# Autodesk Inventor assembly: ARD_Model_v1
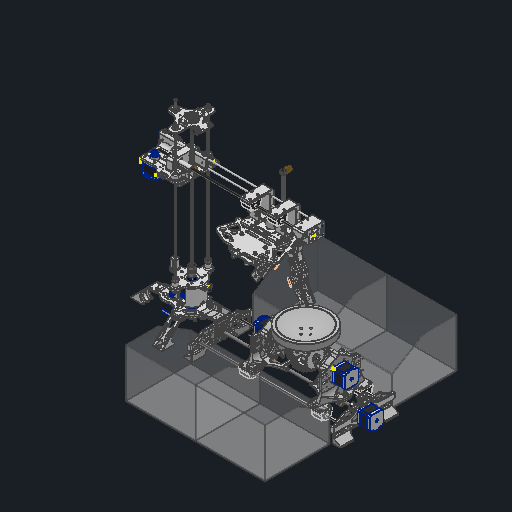
[picture p0: Inventor's stored thumbnail of the model, 512x512]
Saved by Autodesk Inventor 2026.3 (Build 303398000, 398)
## iProperties
Created: 2026-03-18
Part Number: ARD_Model_v1
Document SubType Name: Assembly
Designer: work
Author: work
## Documents named in this file (32)
- C:\Users\khw\Desktop\ARD_v1\ARD_Model_v1.iam
- C:\Users\khw\Desktop\ARD_v1\ARD_hardware\ARD_Model_v1\1\A.ipt
- C:\Users\khw\Desktop\ARD_v1\ARD_hardware\ARD_Model_v1\C.ipt
- C:\Users\khw\Desktop\ARD_v1\ARD_hardware\ARD_Model_v1\Object\JIS B 1521 SKF (D) - SKF 608-Z.ipt
- C:\Users\khw\Desktop\ARD_v1\ARD_hardware\ARD_Model_v1\5_Co.ipt
- C:\Users\khw\Desktop\ARD_v1\ARD_hardware\ARD_Model_v1\NEMA17.ipt
- C:\Users\khw\Desktop\ARD_v1\ARD_hardware\ARD_Model_v1\1\B.ipt
- C:\Users\khw\Desktop\ARD_v1\ARD_hardware\ARD_Model_v1\Object\T8_LeadNut.ipt
- C:\Users\khw\Desktop\ARD_v1\ARD_hardware\ARD_Model_v1\Object\8T_Shaft.ipt
- C:\Users\khw\Desktop\ARD_v1\ARD_hardware\ARD_Model_v1\Object\T8_BellowsCoulping.ipt
- C:\Users\khw\Desktop\ARD_v1\ARD_hardware\ARD_Model_v1\Object\8T_ScrewShaft.ipt
- C:\Users\khw\Desktop\ARD_v1\ARD_hardware\ARD_Model_v1\Object\LeadWay.ipt
- C:\Users\khw\Desktop\ARD_v1\ARD_hardware\ARD_Model_v1\UR_rail_R_LinearWayCopler_v3.ipt
- C:\Users\khw\Desktop\ARD_v1\ARD_hardware\ARD_Model_v1\Object\KS B 1003 - M 3 x 20.ipt
- C:\Users\khw\Desktop\ARD_v1\ARD_hardware\ARD_Model_v1\Object\KS B 1003 - M 3 x 12.ipt
- C:\Users\khw\Desktop\ARD_v1\ARD_hardware\PL121248m2Drive_v2\pl_v1.iam
- C:\Users\khw\Desktop\ARD_v1\ARD_hardware\ARD_Model_v1\UR_rail_LeadNutHolder_v1.ipt
- C:\Users\khw\Desktop\ARD_v1\ARD_hardware\Rali_v1\stand_v2.ipt
- C:\Users\khw\Desktop\ARD_v1\ARD_hardware\Rali_v1\stand1.ipt
- C:\Users\khw\Desktop\ARD_v1\ARD_hardware\Rali_v1\vl53_hoder.ipt
- C:\Users\khw\Desktop\ARD_v1\ARD_hardware\Rali_v1\stand12.ipt
- C:\Users\khw\Desktop\ARD_v1\ARD_hardware\RA_Project\RA_v1.iam
- C:\Users\khw\Desktop\ARD_v1\ARD_hardware\RA_Project\rali-x support_V2.ipt
- C:\Users\khw\Desktop\ARD_v1\ARD_hardware\RA_Project\VL53L0X.ipt
- C:\Users\khw\Desktop\ARD_v1\ARD_hardware\Rali_v1\liner608_holder.ipt
- C:\Users\khw\Desktop\ARD_v1\ARD_hardware\ARD_Model_v1\Object\box big.ipt
- C:\Users\khw\Desktop\ARD_v1\ARD_hardware\ARD_Model_v1\접시.ipt
- C:\Users\khw\Documents\KS B 1003 - M 3 x 10.ipt
- C:\Users\khw\Desktop\ARD_v1\ARD_hardware\ARD_Model_v1\2B_set\AIP\FEA\fdflh83ds.fins
- C:\Users\khw\Desktop\ARD_v1\ARD_hardware\ARD_Model_v1\2B_set\AIP\FEA\fdflh83ds.fsat
- C:\Users\khw\Desktop\ARD_v1\ARD_hardware\ARD_Model_v1\2B_set\AIP\FEA\fdflh83ds.ftes
- C:\Users\khw\Desktop\ARD_v1\ARD_hardware\ARD_Model_v1\2B_set\AIP\FEA\fdflh83ds.fwiz
## Components (121 placed, 27 different names)
1. stand_v2:1 — 메이트:165, 각도:12, 메이트:166, 메이트:167, 각도:16, 메이트:188, 메이트:189, 메이트:190, 메이트:193, 각도:24, 플러쉬:12, 플러쉬:14, 메이트:219, 삽입:34, 삽입:35, 삽입:36, 삽입:37
2. stand1:1 — 메이트:170, 메이트:171, 메이트:172, 메이트:173, 메이트:174, 메이트:175, 메이트:176, 메이트:177, 메이트:178, 플러쉬:10, 각도:14, 삽입:14, 삽입:15, 삽입:16, 삽입:17, 삽입:18, 삽입:19, 삽입:20, 삽입:21
3. stand1:2 — 메이트:179, 메이트:180, 메이트:181, 메이트:182, 메이트:183, 메이트:184, 메이트:185, 플러쉬:9, 메이트:186, 각도:16, 각도:22, 삽입:5, 삽입:6, 삽입:7, 삽입:8, 삽입:9, 삽입:38, 삽입:39, 삽입:40
4. vl53_hoder:1 — 메이트:188, 메이트:189, 메이트:190, 메이트:204, 메이트:205, 각도:21, 삽입:10, 삽입:11, 삽입:12, 삽입:13
5. stand12:1 — 메이트:191, 메이트:192, 각도:17, 메이트:193, 메이트:194
6. stand12:2 — 메이트:196, 메이트:197, 각도:19, 각도:20, 메이트:212, 삽입:26, 삽입:27, 삽입:28, 삽입:29, 메이트:226, 메이트:227
7. RA_v1:1 [sub-assembly] — 각도:19, 각도:20, 메이트:198, 메이트:201, 메이트:202
8. rali-x support_V2:1 — 메이트:198, 메이트:201, 메이트:202, 메이트:209, 메이트:210, 메이트:211
9. VL53L0X:1 — 메이트:204, 메이트:205, 각도:21
10. stand_v2:2 — 메이트:208, 메이트:209, 메이트:210, 메이트:211, 플러쉬:11, 메이트:212, 각도:24, 메이트:213, 메이트:214, 메이트:215, 메이트:218
11. liner608_holder:1 — 메이트:213, 메이트:214, 메이트:215, 메이트:217, 삽입:30, 삽입:31, 삽입:32, 삽입:33
12. JIS B 1521 SKF (D) - SKF 608-Z:5 — 메이트:216, 메이트:217
13. box big:1 — 메이트:218, 플러쉬:12, 메이트:226
14. box big:2 — 플러쉬:14, 메이트:219, 메이트:227
15. 접시:1 — 메이트:222, 메이트:223, 메이트:224, 삽입:22, 삽입:23, 삽입:24, 삽입:25
16. UR_rail_LeadNutHolder_v1:3 — 회전/변환:2, 플러쉬:9, 메이트:186
17. UR_rail_R_LinearWayCopler_v3:1 — 메이트:68, 메이트:69, 메이트:70, 회전:1, 회전:2, 회전:3, 회전:4, 메이트:173, 메이트:174, 메이트:175
18. UR_rail_R_LinearWayCopler_v3:3 — 메이트:176, 메이트:177, 메이트:178
19. B:2 — 회전:3
20. A:1 — 메이트:1, 메이트:2, 메이트:11, 메이트:22, 메이트:23, 회전:1, 메이트:163
21. C:1 — 메이트:7, 메이트:8, 메이트:9, 메이트:10, 메이트:11, 메이트:27, 메이트:50, 플러쉬:3
22. A:2 — 메이트:10, 메이트:21, 메이트:24, 회전:2, 메이트:159, 메이트:162
23. 5_Co:4 — 메이트:22, 메이트:23, 메이트:225
24. 5_Co:3 — 메이트:21, 메이트:24, 회전:3, 메이트:159, 메이트:160, 메이트:161
25. B:1 — 메이트:25, 메이트:26, 메이트:27, 회전:1, 회전:2, 각도:22, 메이트:222, 메이트:223, 메이트:224
26. KS B 1003 - M 3 x 10:1 — 삽입:5
27. KS B 1003 - M 3 x 10:2 — 삽입:6
28. KS B 1003 - M 3 x 10:3 — 삽입:7
29. KS B 1003 - M 3 x 10:4 — 삽입:8
30. KS B 1003 - M 3 x 10:5 — 삽입:9
31. KS B 1003 - M 3 x 10:6 — 삽입:10
32. KS B 1003 - M 3 x 10:7 — 삽입:11
33. KS B 1003 - M 3 x 10:8 — 삽입:12
34. KS B 1003 - M 3 x 10:9 — 삽입:13
35. KS B 1003 - M 3 x 10:10 — 삽입:14
36. KS B 1003 - M 3 x 10:11 — 삽입:15
37. KS B 1003 - M 3 x 10:12 — 삽입:16
38. KS B 1003 - M 3 x 10:13 — 삽입:17
39. KS B 1003 - M 3 x 10:14 — 삽입:18
40. KS B 1003 - M 3 x 10:15 — 삽입:19
41. KS B 1003 - M 3 x 10:16 — 삽입:20
42. KS B 1003 - M 3 x 10:17 — 삽입:21
43. KS B 1003 - M 3 x 10:18 — 삽입:22
44. KS B 1003 - M 3 x 10:19 — 삽입:23
45. KS B 1003 - M 3 x 10:20 — 삽입:24
46. KS B 1003 - M 3 x 10:21 — 삽입:25
47. KS B 1003 - M 3 x 10:22 — 삽입:26
48. KS B 1003 - M 3 x 10:23 — 삽입:27
49. KS B 1003 - M 3 x 10:24 — 삽입:28
50. KS B 1003 - M 3 x 10:25 — 삽입:29
51. KS B 1003 - M 3 x 10:26 — 삽입:30
52. KS B 1003 - M 3 x 10:27 — 삽입:31
53. KS B 1003 - M 3 x 10:28 — 삽입:32
54. KS B 1003 - M 3 x 10:29 — 삽입:33
55. KS B 1003 - M 3 x 10:30 — 삽입:34
56. KS B 1003 - M 3 x 10:31 — 삽입:35
57. KS B 1003 - M 3 x 10:32 — 삽입:36
58. KS B 1003 - M 3 x 10:33 — 삽입:37
59. KS B 1003 - M 3 x 10:34 — 삽입:38
60. KS B 1003 - M 3 x 10:35 — 삽입:39
61. KS B 1003 - M 3 x 10:36 — 삽입:40
62. KS B 1003 - M 3 x 20:27
63. KS B 1003 - M 3 x 20:28
64. KS B 1003 - M 3 x 20:29
65. KS B 1003 - M 3 x 20:30
66. KS B 1003 - M 3 x 20:18 — 회전:31
67. KS B 1003 - M 3 x 20:19 — 회전:32
68. KS B 1003 - M 3 x 20:20 — 삽입:1
69. KS B 1003 - M 3 x 20:21 — 회전:34
70. KS B 1003 - M 3 x 20:22 — 삽입:2, 메이트:171
71. KS B 1003 - M 3 x 20:24 — 회전:35
72. KS B 1003 - M 3 x 20:25 — 회전:33, 메이트:170
73. KS B 1003 - M 3 x 20:26 — 회전:36
74. KS B 1003 - M 3 x 12:8 — 회전:20
75. KS B 1003 - M 3 x 12:5
76. KS B 1003 - M 3 x 12:6
77. KS B 1003 - M 3 x 12:7 — 메이트:134
78. KS B 1003 - M 3 x 20:1 — 회전:1
79. KS B 1003 - M 3 x 20:3 — 회전:3
80. KS B 1003 - M 3 x 20:4 — 회전:2
81. KS B 1003 - M 3 x 20:5 — 회전:4
82. JIS B 1521 SKF (D) - SKF 608-Z:4 — 메이트:50, 플러쉬:3
83. KS B 1003 - M 3 x 20:13
84. KS B 1003 - M 3 x 20:12
85. KS B 1003 - M 3 x 20:11
86. KS B 1003 - M 3 x 20:10
87. KS B 1003 - M 3 x 12:9
88. KS B 1003 - M 3 x 12:10
89. KS B 1003 - M 3 x 12:11
90. KS B 1003 - M 3 x 12:12
91. KS B 1003 - M 3 x 20:31
92. KS B 1003 - M 3 x 20:32
93. KS B 1003 - M 3 x 20:33
94. KS B 1003 - M 3 x 20:34
95. KS B 1003 - M 3 x 20:35
96. KS B 1003 - M 3 x 20:36
97. KS B 1003 - M 3 x 20:37
98. KS B 1003 - M 3 x 20:38 — 메이트:179
99. KS B 1003 - M 3 x 20:39
100. KS B 1003 - M 3 x 20:40
101. KS B 1003 - M 3 x 20:41 — 메이트:180
102. KS B 1003 - M 3 x 20:42
103. UR_rail_LeadNutHolder_v1:2 — 메이트:132, 메이트:133, 메이트:134, 플러쉬:10, 각도:14
104. LeadWay:5 — 메이트:156
105. UR_rail_R_LinearWayCopler_v3:5 — 메이트:181, 메이트:182
106. T8_LeadNut:3 — 메이트:187
107. LeadWay:6 — 메이트:157
108. UR_rail_R_LinearWayCopler_v3:6 — 메이트:183, 메이트:184
109. pl_v1:2 [sub-assembly] — 메이트:161, 메이트:162, 메이트:185
110. pl_v1:1 [sub-assembly] — 회전:31, 회전:32, 삽입:1, 삽입:2, 회전:33, 회전:34, 회전:35, 회전:36, 메이트:160, 메이트:163, 메이트:172, 메이트:225
111. T8_LeadNut:2 — 회전:20, 메이트:132, 메이트:133, 메이트:158
112. 8T_Shaft:2 — 플러쉬:7, 메이트:156, 메이트:194, 메이트:197, 플러쉬:11
113. LeadWay:3
114. NEMA17:3 — 메이트:110, 메이트:111, 각도:10, 각도:12, 메이트:191, 메이트:192, 각도:17
115. 8T_Shaft:1 — 메이트:71, 플러쉬:7, 메이트:157
116. T8_BellowsCoulping:1 — 메이트:84, 메이트:85, 메이트:110, 메이트:111, 회전:4, 각도:10, 회전/변환:2
117. 8T_ScrewShaft:1 — 메이트:84, 메이트:85, 회전:4, 메이트:158, 메이트:165, 메이트:187, 메이트:196, 메이트:208, 메이트:216
118. LeadWay:1 — 메이트:68, 메이트:69, 메이트:70, 메이트:71
119. JIS B 1521 SKF (D) - SKF 608-Z:2 — 메이트:8
120. JIS B 1521 SKF (D) - SKF 608-Z:3 — 메이트:7, 메이트:25, 메이트:26
121. JIS B 1521 SKF (D) - SKF 608-Z:1 — 메이트:1, 메이트:2, 메이트:9
## Relationships (202: Mate 104, Insert 40, RevoluteJoint 34, Angle 10, Flush 7, RelateRotation 4, WeldJoint 2, RelateRotateTranslate 1)
- 메이트:1 [Mate]: A:1 ↔ JIS B 1521 SKF (D) - SKF 608-Z:1
- 메이트:2 [Mate]: A:1 ↔ JIS B 1521 SKF (D) - SKF 608-Z:1
- [Mate]: A:2 ↔ JIS B 1521 SKF (D) - SKF 608-Z:2
- [Mate]: A:2 ↔ JIS B 1521 SKF (D) - SKF 608-Z:2
- 메이트:7 [Mate]: C:1 ↔ JIS B 1521 SKF (D) - SKF 608-Z:3
- 메이트:8 [Mate]: C:1 ↔ JIS B 1521 SKF (D) - SKF 608-Z:2
- 메이트:9 [Mate]: C:1 ↔ JIS B 1521 SKF (D) - SKF 608-Z:1
- 메이트:10 [Mate]: C:1 ↔ A:2
- 메이트:11 [Mate]: A:1 ↔ C:1
- 메이트:21 [Mate]: A:2 ↔ 5_Co:3
- 메이트:22 [Mate]: A:1 ↔ 5_Co:4
- 메이트:23 [Mate]: A:1 ↔ 5_Co:4
- 메이트:24 [Mate]: A:2 ↔ 5_Co:3
- 메이트:25 [Mate]: B:1 ↔ JIS B 1521 SKF (D) - SKF 608-Z:3
- 메이트:26 [Mate]: B:1 ↔ JIS B 1521 SKF (D) - SKF 608-Z:3
- 메이트:27 [Mate]: C:1 ↔ B:1
- 회전:1 [RelateRotation] (1 ul): A:1 ↔ B:1
- 회전:2 [RelateRotation] (1 ul): A:2 ↔ B:1
- [Mate]: B:2 ↔ JIS B 1521 SKF (D) - SKF 608-Z:4
- [Mate]: B:2 ↔ JIS B 1521 SKF (D) - SKF 608-Z:4
- 메이트:50 [Mate]: C:1 ↔ JIS B 1521 SKF (D) - SKF 608-Z:4
- 플러쉬:3 [Flush]: C:1 ↔ JIS B 1521 SKF (D) - SKF 608-Z:4
- 회전:3 [RelateRotation] (1 ul): B:2 ↔ 5_Co:3
- 메이트:68 [Mate]: UR_rail_R_LinearWayCopler_v3:1 ↔ LeadWay:1
- 메이트:69 [Mate]: UR_rail_R_LinearWayCopler_v3:1 ↔ LeadWay:1
- 메이트:70 [Mate]: UR_rail_R_LinearWayCopler_v3:1 ↔ LeadWay:1
- 메이트:71 [Mate]: 8T_Shaft:1 ↔ LeadWay:1
- 회전:1 [RevoluteJoint]: UR_rail_R_LinearWayCopler_v3:1 ↔ KS B 1003 - M 3 x 20:1
- 회전:2 [RevoluteJoint]: UR_rail_R_LinearWayCopler_v3:1 ↔ KS B 1003 - M 3 x 20:4
- 회전:3 [RevoluteJoint]: UR_rail_R_LinearWayCopler_v3:1 ↔ KS B 1003 - M 3 x 20:3
- 회전:4 [RevoluteJoint]: UR_rail_R_LinearWayCopler_v3:1 ↔ KS B 1003 - M 3 x 20:5
- 메이트:84 [Mate]: T8_BellowsCoulping:1 ↔ 8T_ScrewShaft:1
- 메이트:85 [Mate] (-10 mm): T8_BellowsCoulping:1 ↔ 8T_ScrewShaft:1
- [RevoluteJoint]: KS B 1003 - M 3 x 12:5 ↔ T8_LeadNut:2
- [WeldJoint]: KS B 1003 - M 3 x 12:6 ↔ T8_LeadNut:2
- [RevoluteJoint]: KS B 1003 - M 3 x 12:7 ↔ T8_LeadNut:2
- 회전:20 [RevoluteJoint]: KS B 1003 - M 3 x 12:8 ↔ T8_LeadNut:2
- [Mate]: UR_rail_R_LinearWayCopler_v3:3 ↔ LeadWay:3
- [Mate]: UR_rail_R_LinearWayCopler_v3:3 ↔ LeadWay:3
- [Mate]: UR_rail_R_LinearWayCopler_v3:3 ↔ LeadWay:3
- [Mate]: 8T_Shaft:2 ↔ LeadWay:3
- [RevoluteJoint]: UR_rail_R_LinearWayCopler_v3:3 ↔ KS B 1003 - M 3 x 20:10
- [RevoluteJoint]: UR_rail_R_LinearWayCopler_v3:3 ↔ KS B 1003 - M 3 x 20:12
- [RevoluteJoint]: UR_rail_R_LinearWayCopler_v3:3 ↔ KS B 1003 - M 3 x 20:11
- [RevoluteJoint]: UR_rail_R_LinearWayCopler_v3:3 ↔ KS B 1003 - M 3 x 20:13
- 플러쉬:7 [Flush]: 8T_Shaft:2 ↔ 8T_Shaft:1
- 메이트:110 [Mate]: NEMA17:3 ↔ T8_BellowsCoulping:1
- 메이트:111 [Mate] (-10 mm): NEMA17:3 ↔ T8_BellowsCoulping:1
- 회전:4 [RelateRotation] (1 ul): T8_BellowsCoulping:1 ↔ 8T_ScrewShaft:1
- 각도:10 [Angle] (0 deg): NEMA17:3 ↔ T8_BellowsCoulping:1
- 회전:31 [RevoluteJoint]: KS B 1003 - M 3 x 20:18 ↔ pl_v1:1
- 회전:32 [RevoluteJoint]: KS B 1003 - M 3 x 20:19 ↔ pl_v1:1
- 삽입:1 [Insert]: KS B 1003 - M 3 x 20:20 ↔ pl_v1:1
- 삽입:2 [Insert]: KS B 1003 - M 3 x 20:22 ↔ pl_v1:1
- 회전:33 [RevoluteJoint]: KS B 1003 - M 3 x 20:25 ↔ pl_v1:1
- 회전:34 [RevoluteJoint]: KS B 1003 - M 3 x 20:21 ↔ pl_v1:1
- 회전:35 [RevoluteJoint]: KS B 1003 - M 3 x 20:24 ↔ pl_v1:1
- 회전:36 [RevoluteJoint]: KS B 1003 - M 3 x 20:26 ↔ pl_v1:1
- 메이트:132 [Mate]: UR_rail_LeadNutHolder_v1:2 ↔ T8_LeadNut:2
- 메이트:133 [Mate]: UR_rail_LeadNutHolder_v1:2 ↔ T8_LeadNut:2
- 메이트:134 [Mate]: KS B 1003 - M 3 x 12:7 ↔ UR_rail_LeadNutHolder_v1:2
- [Mate]: LeadWay:5 ↔ UR_rail_R_LinearWayCopler_v3:5
- [Mate]: LeadWay:5 ↔ UR_rail_R_LinearWayCopler_v3:5
- [Mate]: LeadWay:5 ↔ UR_rail_R_LinearWayCopler_v3:5
- [RevoluteJoint]: KS B 1003 - M 3 x 20:27 ↔ UR_rail_R_LinearWayCopler_v3:5
- [RevoluteJoint]: KS B 1003 - M 3 x 20:29 ↔ UR_rail_R_LinearWayCopler_v3:5
- [RevoluteJoint]: KS B 1003 - M 3 x 20:28 ↔ UR_rail_R_LinearWayCopler_v3:5
- [RevoluteJoint]: KS B 1003 - M 3 x 20:30 ↔ UR_rail_R_LinearWayCopler_v3:5
- [RevoluteJoint]: KS B 1003 - M 3 x 12:9 ↔ T8_LeadNut:3
- [WeldJoint]: KS B 1003 - M 3 x 12:10 ↔ T8_LeadNut:3
- [RevoluteJoint]: KS B 1003 - M 3 x 12:11 ↔ T8_LeadNut:3
- [RevoluteJoint]: KS B 1003 - M 3 x 12:12 ↔ T8_LeadNut:3
- [Mate]: LeadWay:6 ↔ UR_rail_R_LinearWayCopler_v3:6
- [Mate]: LeadWay:6 ↔ UR_rail_R_LinearWayCopler_v3:6
- [Mate]: LeadWay:6 ↔ UR_rail_R_LinearWayCopler_v3:6
- [RevoluteJoint]: KS B 1003 - M 3 x 20:31 ↔ UR_rail_R_LinearWayCopler_v3:6
- [RevoluteJoint]: KS B 1003 - M 3 x 20:33 ↔ UR_rail_R_LinearWayCopler_v3:6
- [RevoluteJoint]: KS B 1003 - M 3 x 20:32 ↔ UR_rail_R_LinearWayCopler_v3:6
- [RevoluteJoint]: KS B 1003 - M 3 x 20:34 ↔ UR_rail_R_LinearWayCopler_v3:6
- [RevoluteJoint]: KS B 1003 - M 3 x 20:35 ↔ pl_v1:2
- [RevoluteJoint]: KS B 1003 - M 3 x 20:36 ↔ pl_v1:2
- [Insert]: KS B 1003 - M 3 x 20:37 ↔ pl_v1:2
- [Insert]: KS B 1003 - M 3 x 20:39 ↔ pl_v1:2
- [RevoluteJoint]: KS B 1003 - M 3 x 20:41 ↔ pl_v1:2
- [RevoluteJoint]: KS B 1003 - M 3 x 20:38 ↔ pl_v1:2
- [RevoluteJoint]: KS B 1003 - M 3 x 20:40 ↔ pl_v1:2
- [RevoluteJoint]: KS B 1003 - M 3 x 20:42 ↔ pl_v1:2
- [Mate]: UR_rail_LeadNutHolder_v1:3 ↔ T8_LeadNut:3
- [Mate]: UR_rail_LeadNutHolder_v1:3 ↔ T8_LeadNut:3
- [Mate]: UR_rail_LeadNutHolder_v1:3 ↔ KS B 1003 - M 3 x 12:11
- 메이트:156 [Mate]: LeadWay:5 ↔ 8T_Shaft:2
- 메이트:157 [Mate]: LeadWay:6 ↔ 8T_Shaft:1
- 메이트:158 [Mate]: T8_LeadNut:2 ↔ 8T_ScrewShaft:1
- 메이트:159 [Mate]: A:2 ↔ 5_Co:3
- 메이트:160 [Mate]: 5_Co:3 ↔ pl_v1:1
- 메이트:161 [Mate]: 5_Co:3 ↔ pl_v1:2
- 메이트:162 [Mate]: A:2 ↔ pl_v1:2
- 메이트:163 [Mate]: A:1 ↔ pl_v1:1
- 메이트:165 [Mate]: stand_v2:1 ↔ 8T_ScrewShaft:1
- 각도:12 [Angle] (0 deg): stand_v2:1 ↔ NEMA17:3
- 메이트:166 [Mate]: stand_v2:1
- 메이트:167 [Mate]: stand_v2:1
- 회전/변환:2 [RelateRotateTranslate] (8 mm): UR_rail_LeadNutHolder_v1:3 ↔ T8_BellowsCoulping:1
- 메이트:170 [Mate]: stand1:1 ↔ KS B 1003 - M 3 x 20:25
- 메이트:171 [Mate]: stand1:1 ↔ KS B 1003 - M 3 x 20:22
- 메이트:172 [Mate]: stand1:1 ↔ pl_v1:1
- 메이트:173 [Mate]: stand1:1 ↔ UR_rail_R_LinearWayCopler_v3:1
- 메이트:174 [Mate]: stand1:1 ↔ UR_rail_R_LinearWayCopler_v3:1
- 메이트:175 [Mate]: stand1:1 ↔ UR_rail_R_LinearWayCopler_v3:1
- 메이트:176 [Mate]: stand1:1 ↔ UR_rail_R_LinearWayCopler_v3:3
- 메이트:177 [Mate]: stand1:1 ↔ UR_rail_R_LinearWayCopler_v3:3
- 메이트:178 [Mate]: stand1:1 ↔ UR_rail_R_LinearWayCopler_v3:3
- 메이트:179 [Mate]: stand1:2 ↔ KS B 1003 - M 3 x 20:38
- 메이트:180 [Mate]: stand1:2 ↔ KS B 1003 - M 3 x 20:41
- 메이트:181 [Mate]: stand1:2 ↔ UR_rail_R_LinearWayCopler_v3:5
- 메이트:182 [Mate]: stand1:2 ↔ UR_rail_R_LinearWayCopler_v3:5
- 메이트:183 [Mate]: stand1:2 ↔ UR_rail_R_LinearWayCopler_v3:6
- 메이트:184 [Mate]: stand1:2 ↔ UR_rail_R_LinearWayCopler_v3:6
- 메이트:185 [Mate]: stand1:2 ↔ pl_v1:2
- 플러쉬:9 [Flush]: stand1:2 ↔ UR_rail_LeadNutHolder_v1:3
- 메이트:186 [Mate]: stand1:2 ↔ UR_rail_LeadNutHolder_v1:3
- 메이트:187 [Mate]: T8_LeadNut:3 ↔ 8T_ScrewShaft:1
- 플러쉬:10 [Flush]: stand1:1 ↔ UR_rail_LeadNutHolder_v1:2
- 각도:14 [Angle] (0 deg): stand1:1 ↔ UR_rail_LeadNutHolder_v1:2
- 각도:16 [Angle] (0 deg): stand_v2:1 ↔ stand1:2
- 메이트:188 [Mate]: stand_v2:1 ↔ vl53_hoder:1
- 메이트:189 [Mate]: stand_v2:1 ↔ vl53_hoder:1
- 메이트:190 [Mate]: stand_v2:1 ↔ vl53_hoder:1
- 메이트:191 [Mate]: stand12:1 ↔ NEMA17:3
- 메이트:192 [Mate]: stand12:1 ↔ NEMA17:3
- 각도:17 [Angle] (0 deg): stand12:1 ↔ NEMA17:3
- 메이트:193 [Mate]: stand_v2:1 ↔ stand12:1
- 메이트:194 [Mate]: stand12:1 ↔ 8T_Shaft:2
- 메이트:196 [Mate]: stand12:2 ↔ 8T_ScrewShaft:1
- 메이트:197 [Mate] (-32 mm): stand12:2 ↔ 8T_Shaft:2
- 각도:19 [Angle] (0 deg): stand12:2 ↔ RA_v1:1
- 각도:20 [Angle] (0 deg): stand12:2 ↔ RA_v1:1
- 메이트:198 [Mate]: RA_v1:1 ↔ rali-x support_V2:1
- 메이트:201 [Mate]: RA_v1:1 ↔ rali-x support_V2:1
- 메이트:202 [Mate]: RA_v1:1 ↔ rali-x support_V2:1
- 메이트:204 [Mate]: vl53_hoder:1 ↔ VL53L0X:1
- 메이트:205 [Mate]: vl53_hoder:1 ↔ VL53L0X:1
- 각도:21 [Angle] (0 deg): vl53_hoder:1 ↔ VL53L0X:1
- 각도:22 [Angle] (0 deg): stand1:2 ↔ B:1
- 메이트:208 [Mate]: stand_v2:2 ↔ 8T_ScrewShaft:1
- 메이트:209 [Mate]: rali-x support_V2:1 ↔ stand_v2:2
- 메이트:210 [Mate]: rali-x support_V2:1 ↔ stand_v2:2
- 메이트:211 [Mate]: rali-x support_V2:1 ↔ stand_v2:2
- 플러쉬:11 [Flush]: stand_v2:2 ↔ 8T_Shaft:2
- 메이트:212 [Mate]: stand12:2 ↔ stand_v2:2
- 각도:24 [Angle] (0 deg): stand_v2:1 ↔ stand_v2:2
- 메이트:213 [Mate]: stand_v2:2 ↔ liner608_holder:1
- 메이트:214 [Mate]: stand_v2:2 ↔ liner608_holder:1
- 메이트:215 [Mate]: stand_v2:2 ↔ liner608_holder:1
- 메이트:216 [Mate]: JIS B 1521 SKF (D) - SKF 608-Z:5 ↔ 8T_ScrewShaft:1
- 메이트:217 [Mate]: liner608_holder:1 ↔ JIS B 1521 SKF (D) - SKF 608-Z:5
- 메이트:218 [Mate]: stand_v2:2 ↔ box big:1
- 플러쉬:12 [Flush]: stand_v2:1 ↔ box big:1
- 플러쉬:14 [Flush]: stand_v2:1 ↔ box big:2
- 메이트:219 [Mate]: stand_v2:1 ↔ box big:2
- 메이트:222 [Mate]: 접시:1 ↔ B:1
- 메이트:223 [Mate]: 접시:1 ↔ B:1
- 메이트:224 [Mate]: 접시:1 ↔ B:1
- 삽입:5 [Insert]: stand1:2 ↔ KS B 1003 - M 3 x 10:1
- 삽입:6 [Insert]: stand1:2 ↔ KS B 1003 - M 3 x 10:2
- 삽입:7 [Insert]: stand1:2 ↔ KS B 1003 - M 3 x 10:3
- 삽입:8 [Insert]: stand1:2 ↔ KS B 1003 - M 3 x 10:4
- 삽입:9 [Insert]: stand1:2 ↔ KS B 1003 - M 3 x 10:5
- 삽입:10 [Insert]: vl53_hoder:1 ↔ KS B 1003 - M 3 x 10:6
- 삽입:11 [Insert]: vl53_hoder:1 ↔ KS B 1003 - M 3 x 10:7
- 삽입:12 [Insert]: vl53_hoder:1 ↔ KS B 1003 - M 3 x 10:8
- 삽입:13 [Insert]: vl53_hoder:1 ↔ KS B 1003 - M 3 x 10:9
- 삽입:14 [Insert]: stand1:1 ↔ KS B 1003 - M 3 x 10:10
- 삽입:15 [Insert]: stand1:1 ↔ KS B 1003 - M 3 x 10:11
- 삽입:16 [Insert]: stand1:1 ↔ KS B 1003 - M 3 x 10:12
- 삽입:17 [Insert]: stand1:1 ↔ KS B 1003 - M 3 x 10:13
- 삽입:18 [Insert]: stand1:1 ↔ KS B 1003 - M 3 x 10:14
- 삽입:19 [Insert]: stand1:1 ↔ KS B 1003 - M 3 x 10:15
- 삽입:20 [Insert]: stand1:1 ↔ KS B 1003 - M 3 x 10:16
- 삽입:21 [Insert]: stand1:1 ↔ KS B 1003 - M 3 x 10:17
- 삽입:22 [Insert]: 접시:1 ↔ KS B 1003 - M 3 x 10:18
- 삽입:23 [Insert]: 접시:1 ↔ KS B 1003 - M 3 x 10:19
- 삽입:24 [Insert]: 접시:1 ↔ KS B 1003 - M 3 x 10:20
- 삽입:25 [Insert]: 접시:1 ↔ KS B 1003 - M 3 x 10:21
- 삽입:26 [Insert]: stand12:2 ↔ KS B 1003 - M 3 x 10:22
- 삽입:27 [Insert]: stand12:2 ↔ KS B 1003 - M 3 x 10:23
- 삽입:28 [Insert]: stand12:2 ↔ KS B 1003 - M 3 x 10:24
- 삽입:29 [Insert]: stand12:2 ↔ KS B 1003 - M 3 x 10:25
- 삽입:30 [Insert]: liner608_holder:1 ↔ KS B 1003 - M 3 x 10:26
- 삽입:31 [Insert]: liner608_holder:1 ↔ KS B 1003 - M 3 x 10:27
- 삽입:32 [Insert]: liner608_holder:1 ↔ KS B 1003 - M 3 x 10:28
- 삽입:33 [Insert]: liner608_holder:1 ↔ KS B 1003 - M 3 x 10:29
- 삽입:34 [Insert]: stand_v2:1 ↔ KS B 1003 - M 3 x 10:30
- 삽입:35 [Insert]: stand_v2:1 ↔ KS B 1003 - M 3 x 10:31
- 삽입:36 [Insert]: stand_v2:1 ↔ KS B 1003 - M 3 x 10:32
- 삽입:37 [Insert]: stand_v2:1 ↔ KS B 1003 - M 3 x 10:33
- 삽입:38 [Insert]: stand1:2 ↔ KS B 1003 - M 3 x 10:34
- 삽입:39 [Insert]: stand1:2 ↔ KS B 1003 - M 3 x 10:35
- 삽입:40 [Insert]: stand1:2 ↔ KS B 1003 - M 3 x 10:36
- 메이트:225 [Mate]: 5_Co:4 ↔ pl_v1:1
- 메이트:226 [Mate]: stand12:2 ↔ box big:1
- 메이트:227 [Mate]: stand12:2 ↔ box big:2
## Named parameters: d3_d1 = 0 mm, d4_d2 = 0 mm, sa_0 = 10000, d161_d108 = 0 mm, d162_d109 = 0 mm, d267_d244 = 0 mm, d268_d245 = 145.202846 deg, d269_d246 = 0 mm, d270_d249 = 0 mm, d271_d250 = -56.926781 deg, d283_d196 = 0 mm, d284_d197 = 0 mm, d285_d198 = 0 mm, d286_d199 = 0 mm, d287_d200 = 0 mm, d288_d201 = -91.814256 deg, d289_d202 = 0 mm, d290_d203 = -178.39724 deg, d291_d204 = 0 mm, d292_d205 = -45.126225 deg, d293_d206 = 0 mm, d294_d207 = 143.862598 deg, d409_d378 = 0 mm, d410_d379 = 44.776674 deg, d411_d380 = 0 mm, d412_d381 = 112.162478 deg, d413_d382 = 0 mm, d414_d383 = 0 mm, d415_d384 = 0 mm, d416_d385 = 25.873943 deg, d417_d386 = 0 mm, d418_d387 = -165.541755 deg, d419_d267_d244 = 0 mm, d420_d268_d245 = -59.964921 deg, d421_d269_d246 = 0 mm, d422_d270_d249 = 0 mm, d423_d271_d250 = -135.176349 deg, d424_d277 = 0 mm, d425_d278 = -9.563178 deg, d426_d283_d196 = 0 mm, d427_d284_d197 = 0 mm, d428_d285_d198 = 0 mm, d429_d287_d200 = 0 mm, d430_d288_d201 = -75.925419 deg, d431_d289_d202 = 0 mm, d432_d290_d203 = -87.390341 deg, d433_d291_d204 = 0 mm, d434_d292_d205 = 115.283476 deg, d435_d293_d206 = 0 mm, d436_d294_d207 = 143.31193 deg, d437_d206 = 0 mm, d438_d207 = 52.577211 deg, d439_d196 = 0 mm, d440_d197 = 0 mm, d441_d198 = 0 mm, d442_d200 = 0 mm, d443_d201 = 94.724332 deg, d444_d202 = 0 mm, d445_d203 = 161.007542 deg, d446_d204 = 0 mm, d447_d205 = -94.95872 deg, d448_d388 = 0 mm, d449_d389 = -56.3009 deg, d450_d390 = 0 mm, d451_d391 = 85.698581 deg, d458_d403 = 0 mm, d459_d404 = 0 mm, d460_d405 = 0 mm
note: some values were not read from the file. Shown as the stored number, unit unknown: "sa_0".
